# Autodesk Inventor assembly: outer frame
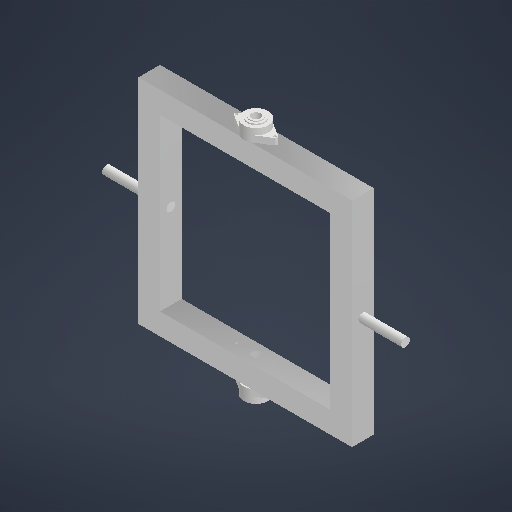
[picture p0: Inventor's stored thumbnail of the model, 512x512]
Saved by Autodesk Inventor 2026.1 (Build 301233000, 233)
## iProperties
Created: 2025-11-11
Part Number: outer frame
Document SubType Name: Assembly
Designer: shiva
Author: shiva
## Documents named in this file (4)
- D:\assignments\SEM 1\CAM\RPM\bigger version\outer sub assembly\outer frame.iam
- D:\assignments\SEM 1\CAM\RPM\bigger version\outer sub assembly\outer frame.ipt
- D:\assignments\SEM 1\CAM\RPM\bigger version\outer sub assembly\axle.ipt
- D:\assignments\SEM 1\CAM\RPM\bigger version\bearing.ipt
## Components (5 placed, 3 different names)
1. outer frame:1 — Mate:1, Mate:2, Flush:1, Flush:2, Mate:3, Mate:4, Mate:5, Mate:6, Mate:7, Mate:8
2. axle:1 — Mate:2, Flush:1
3. axle:2 — Mate:1, Flush:2
4. bearing:1 — Mate:3, Mate:4, Mate:7
5. bearing:2 — Mate:5, Mate:6, Mate:8
## Relationships (10: Mate 8, Flush 2)
- Mate:1: outer frame:1 ↔ axle:2
- Mate:2: outer frame:1 ↔ axle:1
- Flush:1: outer frame:1 ↔ axle:1
- Flush:2: outer frame:1 ↔ axle:2
- Mate:3: outer frame:1 ↔ bearing:1
- Mate:4: outer frame:1 ↔ bearing:1
- Mate:5: outer frame:1 ↔ bearing:2
- Mate:6: outer frame:1 ↔ bearing:2
- Mate:7: outer frame:1 ↔ bearing:1
- Mate:8: outer frame:1 ↔ bearing:2
